# Autodesk Inventor assembly: Assembly1
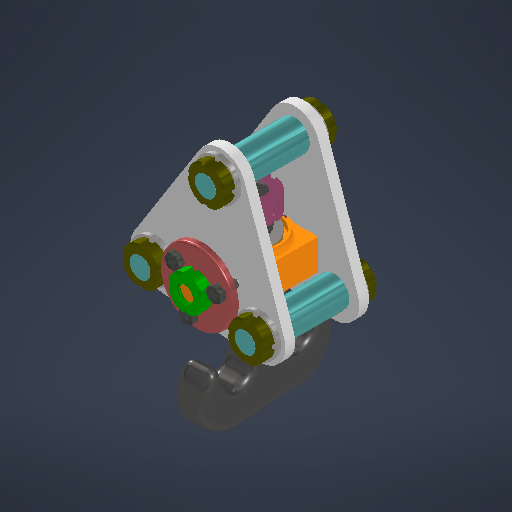
[picture p0: Inventor's stored thumbnail of the model, 512x512]
Saved by Autodesk Inventor 2026.1 (Build 301233020, 233B)
## iProperties
Created: 2026-01-20
Part Number: Assembly1
Document SubType Name: Assembly
Designer: anith
Author: anith
## Documents named in this file (13)
- C:\Users\anith\Downloads\Exam\Assembly1.iam
- C:\Users\anith\Downloads\Exam\1.Crane Hook.ipt
- C:\Users\anith\Downloads\Exam\3.hook ancor.ipt
- C:\Users\anith\Downloads\Exam\6. Bush.ipt
- C:\Users\anith\Downloads\Exam\10. Washer.ipt
- C:\Users\anith\Downloads\Exam\9. Lock Nut M16.ipt
- C:\Users\anith\Downloads\Exam\2. support plate.ipt
- C:\Users\anith\Downloads\Exam\5. Plate Spacer.ipt
- C:\Users\anith\Downloads\Exam\4. End Bush.ipt
- C:\Users\anith\Downloads\Exam\7. Lock Nut M12.ipt
- C:\Users\anith\Downloads\Exam\8. Lock Nut M15.ipt
- C:\Users\anith\OneDrive\Documents\Inventor\Content Center Files\R2026\en-US\DIN EN ISO 4018\DIN EN ISO 4018 - M6x12 - DIN EN ISO 4018.ipt
- C:\Users\anith\OneDrive\Documents\Inventor\Content Center Files\R2026\en-US\ISO 2340 A(1)\ISO 2340 - A - 4 x 26ISO.ipt
## Components (33 placed, 12 different names)
1. 3.hook ancor:1 — Mate:1, Mate:2, Mate:3, Mate:9, Mate:10, Mate:11, Mate:12, Mate:22, Mate:24, Mate:38, Mate:40
2. 1.Crane Hook:1 — Mate:1, Mate:2, Mate:4, Mate:6, Mate:71, Mate:72
3. 6. Bush:1 — Mate:3, Mate:4, Mate:5
4. 10. Washer:1 — Mate:5, Mate:6
5. 9. Lock Nut M16:1 — Mate:71, Mate:72, Mate:73, Mate:74
6. 2. support plate:1 — Mate:9, Mate:10, Mate:15, Mate:16, Mate:18, Mate:19, Mate:20, Mate:23, Mate:25, Mate:26, Mate:27, Mate:56
7. 2. support plate:2 — Mate:11, Mate:12, Mate:13, Mate:14, Mate:17, Mate:21, Mate:31, Mate:32, Mate:51, Mate:55
8. 5. Plate Spacer:1 — Mate:13, Mate:14, Mate:15, Mate:28, Mate:35, Mate:42, Mate:48
9. 5. Plate Spacer:2 — Mate:16, Mate:17, Mate:18, Mate:29, Mate:44, Mate:52, Mate:54
10. 5. Plate Spacer:3 — Mate:19, Mate:20, Mate:30, Mate:36, Mate:46, Mate:50
11. 4. End Bush:1 — Mate:21, Mate:22, Mate:37, Mate:55, Mate:65, Mate:66, Mate:67, Mate:68, Mate:69, Mate:70
12. 4. End Bush:2 — Mate:23, Mate:24, Mate:39, Mate:56, Mate:57, Mate:60, Mate:61, Mate:62, Mate:63, Mate:64
13. 10. Washer:2 — Mate:27, Mate:30, Mate:45
14. 10. Washer:3 — Mate:26, Mate:29, Mate:43
15. 10. Washer:4 — Mate:25, Mate:28, Mate:41
16. 10. Washer:5 — Mate:31, Mate:36, Mate:49
17. 10. Washer:6 — Mate:51, Mate:52, Mate:53
18. 10. Washer:7 — Mate:32, Mate:35, Mate:47
19. 7. Lock Nut M12:1 — Mate:37, Mate:38
20. 7. Lock Nut M12:2 — Mate:39, Mate:40
21. 8. Lock Nut M15:1 — Mate:41, Mate:42
22. 8. Lock Nut M15:2 — Mate:43, Mate:44
23. 8. Lock Nut M15:3 — Mate:45, Mate:46
24. 8. Lock Nut M15:4 — Mate:47, Mate:48
25. 8. Lock Nut M15:5 — Mate:49, Mate:50
26. 8. Lock Nut M15:6 — Mate:53, Mate:54
27. DIN EN ISO 4018 M6x12:1 — Mate:66, Mate:69
28. DIN EN ISO 4018 M6x12:2 — Mate:65, Mate:70
29. DIN EN ISO 4018 M6x12:3 — Mate:63, Mate:64
30. DIN EN ISO 4018 M6x12:5 — Mate:61, Mate:62
31. DIN EN ISO 4018 M6x12:6 — Mate:57, Mate:60
32. DIN EN ISO 4018 M6x12:7 — Mate:67, Mate:68
33. ISO 2340 A A - 4 x 26:1 — Mate:73, Mate:74
## Relationships (68: Mate 68)
- Mate:1: 3.hook ancor:1 ↔ 1.Crane Hook:1
- Mate:2: 3.hook ancor:1 ↔ 1.Crane Hook:1
- Mate:3: 3.hook ancor:1 ↔ 6. Bush:1
- Mate:4: 1.Crane Hook:1 ↔ 6. Bush:1
- Mate:5: 6. Bush:1 ↔ 10. Washer:1
- Mate:6: 1.Crane Hook:1 ↔ 10. Washer:1
- Mate:9: 3.hook ancor:1 ↔ 2. support plate:1
- Mate:10: 3.hook ancor:1 ↔ 2. support plate:1
- Mate:11: 3.hook ancor:1 ↔ 2. support plate:2
- Mate:12: 3.hook ancor:1 ↔ 2. support plate:2
- Mate:13: 2. support plate:2 ↔ 5. Plate Spacer:1
- Mate:14: 2. support plate:2 ↔ 5. Plate Spacer:1
- Mate:15: 2. support plate:1 ↔ 5. Plate Spacer:1
- Mate:16: 2. support plate:1 ↔ 5. Plate Spacer:2
- Mate:17: 2. support plate:2 ↔ 5. Plate Spacer:2
- Mate:18: 2. support plate:1 ↔ 5. Plate Spacer:2
- Mate:19: 2. support plate:1 ↔ 5. Plate Spacer:3
- Mate:20: 2. support plate:1 ↔ 5. Plate Spacer:3
- Mate:21: 2. support plate:2 ↔ 4. End Bush:1
- Mate:22: 3.hook ancor:1 ↔ 4. End Bush:1
- Mate:23: 2. support plate:1 ↔ 4. End Bush:2
- Mate:24: 3.hook ancor:1 ↔ 4. End Bush:2
- Mate:25: 2. support plate:1 ↔ 10. Washer:4
- Mate:26: 2. support plate:1 ↔ 10. Washer:3
- Mate:27: 2. support plate:1 ↔ 10. Washer:2
- Mate:28: 5. Plate Spacer:1 ↔ 10. Washer:4
- Mate:29: 5. Plate Spacer:2 ↔ 10. Washer:3
- Mate:30: 5. Plate Spacer:3 ↔ 10. Washer:2
- Mate:31: 2. support plate:2 ↔ 10. Washer:5
- Mate:32: 2. support plate:2 ↔ 10. Washer:7
- Mate:35: 5. Plate Spacer:1 ↔ 10. Washer:7
- Mate:36: 5. Plate Spacer:3 ↔ 10. Washer:5
- Mate:37: 4. End Bush:1 ↔ 7. Lock Nut M12:1
- Mate:38: 3.hook ancor:1 ↔ 7. Lock Nut M12:1
- Mate:39: 4. End Bush:2 ↔ 7. Lock Nut M12:2
- Mate:40: 3.hook ancor:1 ↔ 7. Lock Nut M12:2
- Mate:41: 10. Washer:4 ↔ 8. Lock Nut M15:1
- Mate:42: 5. Plate Spacer:1 ↔ 8. Lock Nut M15:1
- Mate:43: 10. Washer:3 ↔ 8. Lock Nut M15:2
- Mate:44: 5. Plate Spacer:2 ↔ 8. Lock Nut M15:2
- Mate:45: 10. Washer:2 ↔ 8. Lock Nut M15:3
- Mate:46: 5. Plate Spacer:3 ↔ 8. Lock Nut M15:3
- Mate:47: 10. Washer:7 ↔ 8. Lock Nut M15:4
- Mate:48: 5. Plate Spacer:1 ↔ 8. Lock Nut M15:4
- Mate:49: 10. Washer:5 ↔ 8. Lock Nut M15:5
- Mate:50: 5. Plate Spacer:3 ↔ 8. Lock Nut M15:5
- Mate:51: 2. support plate:2 ↔ 10. Washer:6
- Mate:52: 5. Plate Spacer:2 ↔ 10. Washer:6
- Mate:53: 10. Washer:6 ↔ 8. Lock Nut M15:6
- Mate:54: 5. Plate Spacer:2 ↔ 8. Lock Nut M15:6
- Mate:55: 2. support plate:2 ↔ 4. End Bush:1
- Mate:56: 2. support plate:1 ↔ 4. End Bush:2
- Mate:57: 4. End Bush:2 ↔ DIN EN ISO 4018 M6x12:6
- Mate:60: 4. End Bush:2 ↔ DIN EN ISO 4018 M6x12:6
- Mate:61: 4. End Bush:2 ↔ DIN EN ISO 4018 M6x12:5
- Mate:62: 4. End Bush:2 ↔ DIN EN ISO 4018 M6x12:5
- Mate:63: 4. End Bush:2 ↔ DIN EN ISO 4018 M6x12:3
- Mate:64: 4. End Bush:2 ↔ DIN EN ISO 4018 M6x12:3
- Mate:65: 4. End Bush:1 ↔ DIN EN ISO 4018 M6x12:2
- Mate:66: 4. End Bush:1 ↔ DIN EN ISO 4018 M6x12:1
- Mate:67: 4. End Bush:1 ↔ DIN EN ISO 4018 M6x12:7
- Mate:68: 4. End Bush:1 ↔ DIN EN ISO 4018 M6x12:7
- Mate:69: 4. End Bush:1 ↔ DIN EN ISO 4018 M6x12:1
- Mate:70: 4. End Bush:1 ↔ DIN EN ISO 4018 M6x12:2
- Mate:71: 1.Crane Hook:1 ↔ 9. Lock Nut M16:1
- Mate:72: 1.Crane Hook:1 ↔ 9. Lock Nut M16:1
- Mate:73: 9. Lock Nut M16:1 ↔ ISO 2340 A A - 4 x 26:1
- Mate:74: 9. Lock Nut M16:1 ↔ ISO 2340 A A - 4 x 26:1
